# Autodesk Inventor assembly: Power Cable Assembly
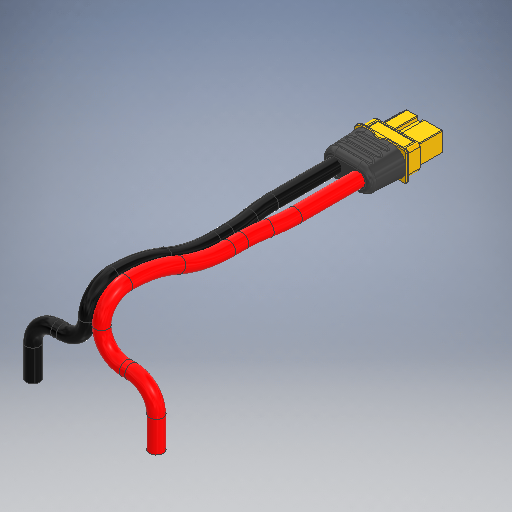
[picture p0: Inventor's stored thumbnail of the model, 512x512]
Saved by Autodesk Inventor 2025 (Build 290162010, 162A)
## iProperties
Created: 2025-08-20
Part Number: Power Cable Assembly
Document SubType Name: Assembly
Designer: Glen Collingwood
Author: Glen Collingwood
## Documents named in this file (3)
- D:\MISCELLANEOUS\Inventor Projects\SSN 744 Block V (1-100)\Battery\Power Cable Assembly.iam
- D:\MISCELLANEOUS\Inventor Projects\SSN 744 Block V (1-100)\Battery\XT60H - Female.ipt
- D:\MISCELLANEOUS\Inventor Projects\SSN 744 Block V (1-100)\Battery\Power Cable.ipt
## Components (2 placed, 2 different names)
1. XT60H - Female:1 — Mate:1, Mate:2, Mate:3
2. Power Cable:1 — Mate:1, Mate:2, Mate:3
## Relationships (3: Mate 3)
- Mate:1: XT60H - Female:1 ↔ Power Cable:1
- Mate:2: XT60H - Female:1 ↔ Power Cable:1
- Mate:3 (0.5 mm): XT60H - Female:1 ↔ Power Cable:1
